# Autodesk Inventor assembly: ASSEMBLY_REF_Ant_Stand
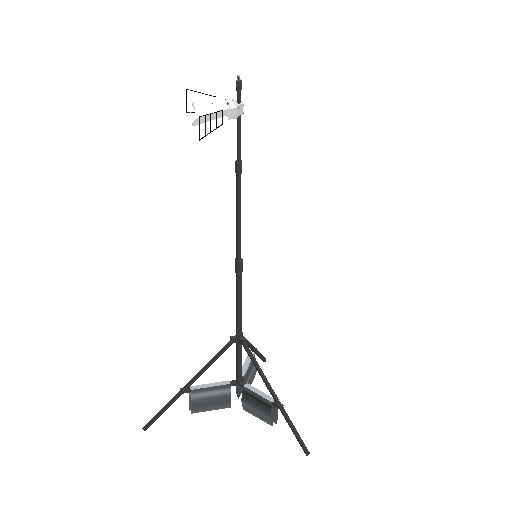
[picture p0: Inventor's stored thumbnail of the model, 512x512]
Saved by Autodesk Inventor 2027 (Build 310192060, 192F)
## iProperties
Created: 2026-01-18
Part Number: ASSEMBLY_REF_Ant_Stand
Document SubType Name: Assembly
Designer: Andrzej
Author: Andrzej
## Documents named in this file (9)
- C:\Users\lacze\OneDrive\_DRIVE_SYNCH_FILES\RF - Antenna Positioner\MCAD\1_V1\ASSEMBLY_REF_ANT_STAND_REVA\ASSEMBLY_REF_Ant_Stand.iam
- C:\Users\lacze\OneDrive\_DRIVE_SYNCH_FILES\RF - Antenna Positioner\MCAD\1_V1\__COTS_PARTS\COTS_GlareOne_A-275_Tripod\COTS_GlareOne_A-275_Tripod_Extended.iam
- C:\Users\lacze\OneDrive\_DRIVE_SYNCH_FILES\RF - Antenna Positioner\MCAD\1_V1\__COTS_PARTS\COTS_BYTECHLAB_DUAL_RIDGED_HORN_REFERENCE\COTS_BYTECHLAB_Dual_Ridged_Horn_Reference.iam
- C:\Users\lacze\OneDrive\_DRIVE_SYNCH_FILES\RF - Antenna Positioner\MCAD\1_V1\__COTS_PARTS\COTS_PROFOTO_Tripod_Sandbag.ipt
- C:\Users\lacze\OneDrive\_DRIVE_SYNCH_FILES\RF - Antenna Positioner\MCAD\1_V1\ASSEMBLY_REF_ANT_STAND_REVA\3DP_PLA_REF_Ant_Mounting_Bracket.ipt
- C:\Users\lacze\OneDrive\_DRIVE_SYNCH_FILES\RF - Antenna Positioner\MCAD\1_V1\__CONTENT_CENTER_PARTS\en-US\DIN 912\DIN 912 - M5 x 0,8 x 20 x 18.ipt
- C:\Users\lacze\OneDrive\_DRIVE_SYNCH_FILES\RF - Antenna Positioner\MCAD\1_V1\ASSEMBLY_REF_ANT_STAND_REVA\3DP_PLA_REF_Ant_Mounting_Bracket_Clamp.ipt
- C:\Users\lacze\OneDrive\_DRIVE_SYNCH_FILES\RF - Antenna Positioner\MCAD\1_V1\__CONTENT_CENTER_PARTS\en-US\DIN 912\DIN 912 - M5 x 0,8 x 40 x 22.ipt
- C:\Users\lacze\OneDrive\_DRIVE_SYNCH_FILES\RF - Antenna Positioner\MCAD\1_V1\__CONTENT_CENTER_PARTS\en-US\DIN 934\DIN 934 - M5 x 0,8.ipt
## Components (19 placed, 8 different names)
1. COTS_GlareOne_A-275_Tripod_Extended:1 [sub-assembly] — Mate:1, Mate:2, Mate:3, Angle:1, Mate:14, Mate:15, Mate:32
2. COTS_BYTECHLAB_Dual_Ridged_Horn_Reference:1 [sub-assembly] — Mate:4, Flush:1, Flush:2, Angle:1
3. 3DP_PLA_REF_Ant_Mounting_Bracket:1 — Mate:4, Flush:1, Flush:2, Mate:6, Mate:7, Mate:8, Mate:9, Mate:10, Mate:11, Mate:12, Mate:13, Mate:14, Flush:3, Flush:4, Mate:25, Mate:27, Mate:29, Mate:31, Angle:2, Angle:3, Angle:4, Angle:5, Mate:32
4. DIN 912 - replaced by DIN EN ISO 4762 M5 x 20:1 — Mate:6, Mate:7
5. DIN 912 - replaced by DIN EN ISO 4762 M5 x 20:2 — Mate:8, Mate:9
6. DIN 912 - replaced by DIN EN ISO 4762 M5 x 20:3 — Mate:10, Mate:11
7. DIN 912 - replaced by DIN EN ISO 4762 M5 x 20:4 — Mate:12, Mate:13
8. 3DP_PLA_REF_Ant_Mounting_Bracket_Clamp:1 — Mate:15, Flush:3, Flush:4, Mate:16, Mate:17, Mate:18, Mate:19, Mate:20, Mate:21, Mate:22, Mate:23, Mate:24, Mate:26, Mate:28, Mate:30
9. DIN 912 - replaced by DIN EN ISO 4762 M5 x 40:1 — Mate:16, Mate:17
10. DIN 934 - replaced by DIN EN 24032/28673/28674 M5:1 — Mate:24, Mate:25, Angle:2
11. DIN 912 - replaced by DIN EN ISO 4762 M5 x 40:2 — Mate:18, Mate:19
12. DIN 912 - replaced by DIN EN ISO 4762 M5 x 40:3 — Mate:20, Mate:21
13. DIN 912 - replaced by DIN EN ISO 4762 M5 x 40:4 — Mate:22, Mate:23
14. DIN 934 - replaced by DIN EN 24032/28673/28674 M5:2 — Mate:26, Mate:27, Angle:5
15. DIN 934 - replaced by DIN EN 24032/28673/28674 M5:3 — Mate:28, Mate:29, Angle:4
16. DIN 934 - replaced by DIN EN 24032/28673/28674 M5:4 — Mate:30, Mate:31, Angle:3
17. COTS_PROFOTO_Tripod_Sandbag:1 — Mate:1, Mate:2, Mate:3
18. COTS_PROFOTO_Tripod_Sandbag:2
19. COTS_PROFOTO_Tripod_Sandbag:3
## Component patterns: (3 elements, first: COTS_PROFOTO_Tripod_Sandbag:1)
## Relationships (40: Mate 31, Angle 5, Flush 4)
- Mate:1: COTS_GlareOne_A-275_Tripod_Extended:1 ↔ COTS_PROFOTO_Tripod_Sandbag:1
- Mate:2: COTS_GlareOne_A-275_Tripod_Extended:1 ↔ COTS_PROFOTO_Tripod_Sandbag:1
- Mate:3: COTS_GlareOne_A-275_Tripod_Extended:1 ↔ COTS_PROFOTO_Tripod_Sandbag:1
- Mate:4: COTS_BYTECHLAB_Dual_Ridged_Horn_Reference:1 ↔ 3DP_PLA_REF_Ant_Mounting_Bracket:1
- Flush:1: COTS_BYTECHLAB_Dual_Ridged_Horn_Reference:1 ↔ 3DP_PLA_REF_Ant_Mounting_Bracket:1
- Flush:2: COTS_BYTECHLAB_Dual_Ridged_Horn_Reference:1 ↔ 3DP_PLA_REF_Ant_Mounting_Bracket:1
- Angle:1 (180 deg): COTS_GlareOne_A-275_Tripod_Extended:1 ↔ COTS_BYTECHLAB_Dual_Ridged_Horn_Reference:1
- Mate:6: 3DP_PLA_REF_Ant_Mounting_Bracket:1 ↔ DIN 912 - replaced by DIN EN ISO 4762 M5 x 20:1
- Mate:7: 3DP_PLA_REF_Ant_Mounting_Bracket:1 ↔ DIN 912 - replaced by DIN EN ISO 4762 M5 x 20:1
- Mate:8: 3DP_PLA_REF_Ant_Mounting_Bracket:1 ↔ DIN 912 - replaced by DIN EN ISO 4762 M5 x 20:2
- Mate:9: 3DP_PLA_REF_Ant_Mounting_Bracket:1 ↔ DIN 912 - replaced by DIN EN ISO 4762 M5 x 20:2
- Mate:10: 3DP_PLA_REF_Ant_Mounting_Bracket:1 ↔ DIN 912 - replaced by DIN EN ISO 4762 M5 x 20:3
- Mate:11: 3DP_PLA_REF_Ant_Mounting_Bracket:1 ↔ DIN 912 - replaced by DIN EN ISO 4762 M5 x 20:3
- Mate:12: 3DP_PLA_REF_Ant_Mounting_Bracket:1 ↔ DIN 912 - replaced by DIN EN ISO 4762 M5 x 20:4
- Mate:13: 3DP_PLA_REF_Ant_Mounting_Bracket:1 ↔ DIN 912 - replaced by DIN EN ISO 4762 M5 x 20:4
- Mate:14: COTS_GlareOne_A-275_Tripod_Extended:1 ↔ 3DP_PLA_REF_Ant_Mounting_Bracket:1
- Mate:15: COTS_GlareOne_A-275_Tripod_Extended:1 ↔ 3DP_PLA_REF_Ant_Mounting_Bracket_Clamp:1
- Flush:3: 3DP_PLA_REF_Ant_Mounting_Bracket:1 ↔ 3DP_PLA_REF_Ant_Mounting_Bracket_Clamp:1
- Flush:4: 3DP_PLA_REF_Ant_Mounting_Bracket:1 ↔ 3DP_PLA_REF_Ant_Mounting_Bracket_Clamp:1
- Mate:16: 3DP_PLA_REF_Ant_Mounting_Bracket_Clamp:1 ↔ DIN 912 - replaced by DIN EN ISO 4762 M5 x 40:1
- Mate:17: 3DP_PLA_REF_Ant_Mounting_Bracket_Clamp:1 ↔ DIN 912 - replaced by DIN EN ISO 4762 M5 x 40:1
- Mate:18: 3DP_PLA_REF_Ant_Mounting_Bracket_Clamp:1 ↔ DIN 912 - replaced by DIN EN ISO 4762 M5 x 40:2
- Mate:19: 3DP_PLA_REF_Ant_Mounting_Bracket_Clamp:1 ↔ DIN 912 - replaced by DIN EN ISO 4762 M5 x 40:2
- Mate:20: 3DP_PLA_REF_Ant_Mounting_Bracket_Clamp:1 ↔ DIN 912 - replaced by DIN EN ISO 4762 M5 x 40:3
- Mate:21: 3DP_PLA_REF_Ant_Mounting_Bracket_Clamp:1 ↔ DIN 912 - replaced by DIN EN ISO 4762 M5 x 40:3
- Mate:22: 3DP_PLA_REF_Ant_Mounting_Bracket_Clamp:1 ↔ DIN 912 - replaced by DIN EN ISO 4762 M5 x 40:4
- Mate:23: 3DP_PLA_REF_Ant_Mounting_Bracket_Clamp:1 ↔ DIN 912 - replaced by DIN EN ISO 4762 M5 x 40:4
- Mate:24: 3DP_PLA_REF_Ant_Mounting_Bracket_Clamp:1 ↔ DIN 934 - replaced by DIN EN 24032/28673/28674 M5:1
- Mate:25: 3DP_PLA_REF_Ant_Mounting_Bracket:1 ↔ DIN 934 - replaced by DIN EN 24032/28673/28674 M5:1
- Mate:26: 3DP_PLA_REF_Ant_Mounting_Bracket_Clamp:1 ↔ DIN 934 - replaced by DIN EN 24032/28673/28674 M5:2
- Mate:27: 3DP_PLA_REF_Ant_Mounting_Bracket:1 ↔ DIN 934 - replaced by DIN EN 24032/28673/28674 M5:2
- Mate:28: 3DP_PLA_REF_Ant_Mounting_Bracket_Clamp:1 ↔ DIN 934 - replaced by DIN EN 24032/28673/28674 M5:3
- Mate:29: 3DP_PLA_REF_Ant_Mounting_Bracket:1 ↔ DIN 934 - replaced by DIN EN 24032/28673/28674 M5:3
- Mate:30: 3DP_PLA_REF_Ant_Mounting_Bracket_Clamp:1 ↔ DIN 934 - replaced by DIN EN 24032/28673/28674 M5:4
- Mate:31: 3DP_PLA_REF_Ant_Mounting_Bracket:1 ↔ DIN 934 - replaced by DIN EN 24032/28673/28674 M5:4
- Angle:2 (0 deg): 3DP_PLA_REF_Ant_Mounting_Bracket:1 ↔ DIN 934 - replaced by DIN EN 24032/28673/28674 M5:1
- Angle:3 (0 deg): 3DP_PLA_REF_Ant_Mounting_Bracket:1 ↔ DIN 934 - replaced by DIN EN 24032/28673/28674 M5:4
- Angle:4 (0 deg): 3DP_PLA_REF_Ant_Mounting_Bracket:1 ↔ DIN 934 - replaced by DIN EN 24032/28673/28674 M5:3
- Angle:5 (0 deg): 3DP_PLA_REF_Ant_Mounting_Bracket:1 ↔ DIN 934 - replaced by DIN EN 24032/28673/28674 M5:2
- Mate:32 (75 mm): COTS_GlareOne_A-275_Tripod_Extended:1 ↔ 3DP_PLA_REF_Ant_Mounting_Bracket:1
